# Autodesk Inventor assembly: Assembly1
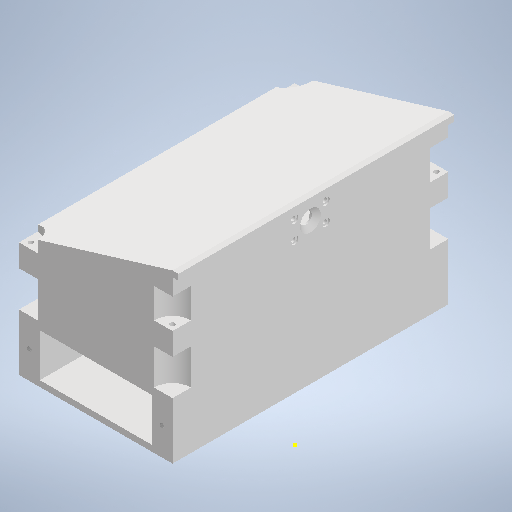
[picture p0: Inventor's stored thumbnail of the model, 512x512]
Saved by Autodesk Inventor 2025 (Build 290162000, 162)
## iProperties
Created: 2026-05-27
Part Number: Assembly1
Document SubType Name: Assembly
Designer: User
Author: User
## Documents named in this file (4)
- C:\Users\User\Desktop\zad\Assembly1.iam
- C:\Users\User\Desktop\zad\Part1.ipt
- C:\Users\User\Desktop\zad\part3.ipt
- C:\Users\User\Desktop\zad\assemb.ipt
## Components (3 placed, 3 different names)
1. Part1:1 — Mate:1, Mate:2
2. part3:1 — Mate:1, Mate:2
3. assemb:1
## Relationships (2: Mate 2)
- Mate:1: Part1:1 ↔ part3:1
- Mate:2: Part1:1 ↔ part3:1
